# Autodesk Inventor assembly: gate_and-b
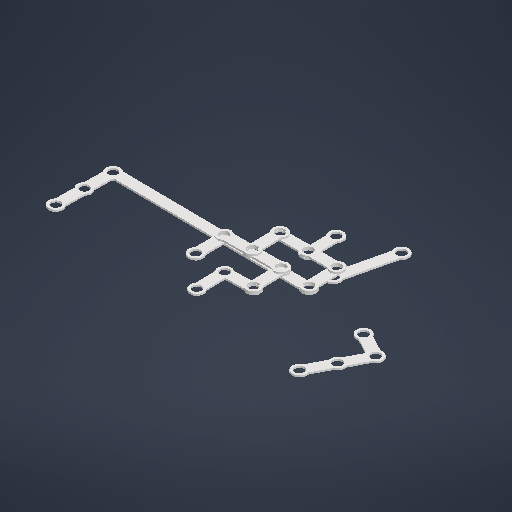
[picture p0: Inventor's stored thumbnail of the model, 512x512]
Saved by Autodesk Inventor 2025.4 (Build 294407000, 407)
## iProperties
Created: 2026-10-11
Part Number: gate_and-b
Document SubType Name: Assembly
Designer: User
Author: User
## Documents named in this file (11)
- G:\projects\primary\mechanical-computer\mechanics\gates\gate_and-b.iam
- G:\projects\primary\mechanical-computer\mechanics\links\link-1-turn-rigid.ipt
- G:\projects\primary\mechanical-computer\mechanics\links\link-1-turn-rigid\link-1-turn-rigid-7(_AS)8w-8l.ipt
- G:\projects\primary\mechanical-computer\mechanics\links\link\link-8.ipt
- G:\projects\primary\mechanical-computer\mechanics\links\link.ipt
- G:\projects\primary\mechanical-computer\mechanics\links\link-split\link-split-8ab.ipt
- G:\projects\primary\mechanical-computer\mechanics\links\link-split.ipt
- G:\projects\primary\mechanical-computer\mechanics\links\link-1-turn-rigid\link-1-turn-rigid-8.ipt
- G:\projects\primary\mechanical-computer\mechanics\links\link-1-turn\link-1-turn-8.ipt
- G:\projects\primary\mechanical-computer\mechanics\links\link-1-turn.ipt
- G:\projects\primary\mechanical-computer\mechanics\links\link\link-8(_AS)2.ipt
## Components (11 placed, 6 different names)
1. link-1-turn-rigid-7(_AS)8w-8l:1 — Cylindrical:7, Mate:7
2. link-8:1 — Cylindrical:1, Mate:1
3. link-8:2 — Cylindrical:6, Mate:6, Cylindrical:7, Mate:7
4. link-8:3 — Cylindrical:4, Mate:4, Cylindrical:5, Mate:5
5. link-8:4 — Cylindrical:2, Mate:2, Cylindrical:8
6. link-split-8ab:1 — Cylindrical:1, Mate:1, Cylindrical:2, Mate:2, Cylindrical:4, Mate:4
7. link-split-8ab:2 — Cylindrical:5, Cylindrical:6, Mate:5, Mate:6, Cylindrical:9, Mate:8
8. link-1-turn-8:1 — Cylindrical:8, Flush:1
9. link-1-turn-rigid-8:3 — Cylindrical:10, Mate:9, Flush:1
10. link-8:5 — Cylindrical:9, Mate:8
11. link-8(_AS)2:6 — Cylindrical:10, Mate:9
## Relationships (19: CylindricalJoint 9, Mate 9, Flush 1)
- Cylindrical:1: link-8:1 ↔ link-split-8ab:1
- Mate:1: link-8:1 ↔ link-split-8ab:1
- Cylindrical:2: link-8:4 ↔ link-split-8ab:1
- Mate:2: link-8:4 ↔ link-split-8ab:1
- [Mate]: link-8:4 ↔ link-1-turn-8:1
- Cylindrical:4: link-8:3 ↔ link-split-8ab:1
- Mate:4: link-8:3 ↔ link-split-8ab:1
- Cylindrical:5: link-8:3 ↔ link-split-8ab:2
- Cylindrical:6: link-8:2 ↔ link-split-8ab:2
- Mate:5: link-8:3 ↔ link-split-8ab:2
- Mate:6: link-8:2 ↔ link-split-8ab:2
- Cylindrical:7: link-1-turn-rigid-7(_AS)8w-8l:1 ↔ link-8:2
- Cylindrical:8: link-8:4 ↔ link-1-turn-8:1
- Mate:7: link-1-turn-rigid-7(_AS)8w-8l:1 ↔ link-8:2
- Cylindrical:9: link-split-8ab:2 ↔ link-8:5
- Mate:8: link-split-8ab:2 ↔ link-8:5
- Cylindrical:10: link-1-turn-rigid-8:3 ↔ link-8(_AS)2:6
- Mate:9: link-1-turn-rigid-8:3 ↔ link-8(_AS)2:6
- Flush:1: link-1-turn-8:1 ↔ link-1-turn-rigid-8:3
